# Autodesk Inventor assembly: table_arm
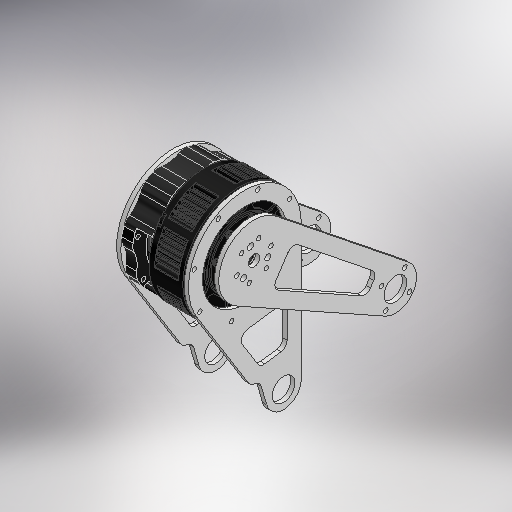
[picture p0: Inventor's stored thumbnail of the model, 512x512]
Saved by Autodesk Inventor 2025.3 (Build 293356030, 356C)
## iProperties
Created: 2026-01-04
Part Number: table_arm
Document SubType Name: Assembly
Designer: ibuki_ono
Author: ibuki_ono
## Documents named in this file (8)
- C:\Users\ibuki_ono\Documents\hobby\rogiken\catchrobo\2026_CAD\Hardware_2026\Inventor\base_table\table_arm.iam
- C:\Users\ibuki_ono\Documents\hobby\rogiken\catchrobo\2026_CAD\Hardware_2026\Inventor\base_table\CP4.0_base-arm1.ipt
- C:\Users\ibuki_ono\Documents\hobby\rogiken\catchrobo\2026_CAD\Hardware_2026\Inventor\base_table\GIM6010-8\GIM6010-8.iam
- C:\Users\ibuki_ono\Documents\hobby\rogiken\catchrobo\2026_CAD\Hardware_2026\Inventor\base_table\3D_motor-spacer.ipt
- C:\Users\ibuki_ono\Documents\hobby\rogiken\catchrobo\2026_CAD\Hardware_2026\Inventor\base_table\CP4.0_base-arm2.ipt
- C:\Users\ibuki_ono\Documents\hobby\rogiken\catchrobo\2026_CAD\Hardware_2026\Inventor\base_table\6810ZZ.ipt
- C:\Users\ibuki_ono\Documents\hobby\rogiken\catchrobo\2026_CAD\Hardware_2026\Inventor\base_table\3D_plate-spacer.ipt
- C:\Users\ibuki_ono\Documents\hobby\rogiken\catchrobo\2026_CAD\Hardware_2026\Inventor\base_table\3D_sub-motor.ipt
## Components (9 placed, 7 different names)
1. GIM6010-8:1 [sub-assembly] — 挿入:5, 挿入:6, 挿入:8, 挿入:9, 挿入:10, メイト:9, メイト:10, 挿入:13
2. CP4.0_base-arm2:1 — 挿入:5, 挿入:6, 角度:1, メイト:2
3. CP4.0_base-arm2:2 — メイト:1, 角度:1, メイト:2, メイト:3, メイト:8
4. 6810ZZ:1 — メイト:1, メイト:3, メイト:4, メイト:6, メイト:7
5. 3D_motor-spacer:1 — 挿入:8, メイト:4, 挿入:13
6. CP4.0_base-arm1:1 — 挿入:11, 角度:2, メイト:5
7. 3D_plate-spacer:1 — 挿入:9, 挿入:10, 挿入:11
8. CP4.0_base-arm1:2 — 角度:2, メイト:5, 挿入:12
9. 3D_sub-motor:1 — メイト:6, メイト:7, 挿入:12
## Relationships (20: Mate 10, Insert 8, Angle 2)
- 挿入:5 [Insert]: GIM6010-8:1 ↔ CP4.0_base-arm2:1
- 挿入:6 [Insert]: GIM6010-8:1 ↔ CP4.0_base-arm2:1
- メイト:1 [Mate]: CP4.0_base-arm2:2 ↔ 6810ZZ:1
- 角度:1 [Angle] (0 deg): CP4.0_base-arm2:1 ↔ CP4.0_base-arm2:2
- メイト:2 [Mate]: CP4.0_base-arm2:1 ↔ CP4.0_base-arm2:2
- メイト:3 [Mate]: CP4.0_base-arm2:2 ↔ 6810ZZ:1
- 挿入:8 [Insert]: GIM6010-8:1 ↔ 3D_motor-spacer:1
- メイト:4 [Mate]: 6810ZZ:1 ↔ 3D_motor-spacer:1
- 挿入:9 [Insert]: GIM6010-8:1 ↔ 3D_plate-spacer:1
- 挿入:10 [Insert]: GIM6010-8:1 ↔ 3D_plate-spacer:1
- 挿入:11 [Insert]: CP4.0_base-arm1:1 ↔ 3D_plate-spacer:1
- 角度:2 [Angle] (0 deg): CP4.0_base-arm1:1 ↔ CP4.0_base-arm1:2
- メイト:5 [Mate]: CP4.0_base-arm1:1 ↔ CP4.0_base-arm1:2
- メイト:6 [Mate]: 6810ZZ:1 ↔ 3D_sub-motor:1
- メイト:7 [Mate]: 6810ZZ:1 ↔ 3D_sub-motor:1
- 挿入:12 [Insert]: CP4.0_base-arm1:2 ↔ 3D_sub-motor:1
- メイト:8 [Mate]: CP4.0_base-arm2:2
- メイト:9 [Mate]: GIM6010-8:1
- メイト:10 [Mate]: GIM6010-8:1
- 挿入:13 [Insert]: GIM6010-8:1 ↔ 3D_motor-spacer:1
